# Autodesk Inventor assembly: MM0937AN100_G13_505
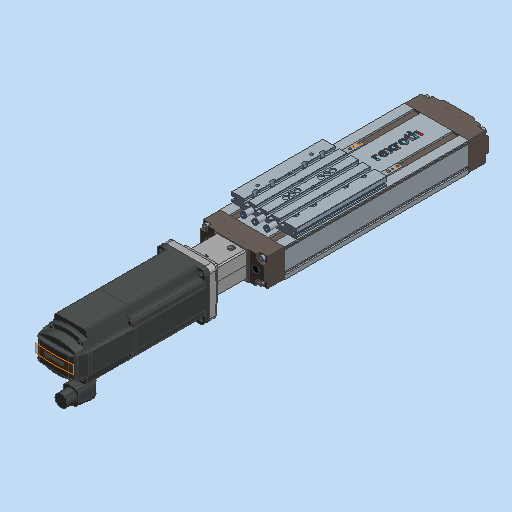
[picture p0: Inventor's stored thumbnail of the model, 512x512]
Saved by Autodesk Inventor 2023.3 (Build 273359000, 359)
## iProperties
Created: 2023-11-29
Part Number: MM0937AN100_G13_505
Document SubType Name: Baugruppe
Designer: RIC7AN
Mass: 24183.6 g
Surface Area: 5600.76 cm^2
Volume: 2935.35 cm^3
Density: 8.23876 g/cm^3
Description: =<RBPARTNOTITLE2>
Vendor: Bosch Rexroth
Sending System: CREO PARAMETRIC BY PTC INC, 2021072
Preprocessor: CREO PARAMETRIC BY PTC INC, 2021072
RBPARTMADEOF: siehe Zeichnung
RBDRAWINGMISSINGSPEC: --
AnP_Kategorie: 11
RBPARTNOTITLE2: CKK110 (L=315mm, P=5mm)
RBGBREMARKSINDEX: E
RBSURFACE: --
RBPARTNOTITLE1: CKK110 (L=315mm, P=5mm)
AnP_Material: =<Material>
RBMATERIAL: =<Material>
RBMATNO: =<Part Number>
RBPARTNO: SIEHE MNR
Title: R036040000_315_ASM
Author: ac91sw
Keywords: =<RBPARTMADEOF>
Comments: =<RBSURFACE2>
Revision Number: 01
## Documents named in this file (3)
- C:\Users\rea9an\Documents\Inventor\TCAI2412_te1910_EM\AS00000907.iam
- C:\Users\rea9an\Documents\Inventor\TCAI2412_te1910_EM\PT00004547.ipt
- C:\Users\rea9an\Documents\Inventor\TCAI2412_te1910_EM\PT00004548.ipt
## Components (2 placed, 2 different names)
1. PT00004547:1 — Fluchtend:3, Fluchtend:4, Passend:2
2. PT00004548:1 — Fluchtend:3, Fluchtend:4, Passend:2
## Relationships (3: Flush 2, Mate 1)
- Fluchtend:3 [Flush]: PT00004547:1 ↔ PT00004548:1
- Fluchtend:4 [Flush] (-17 mm): PT00004547:1 ↔ PT00004548:1
- Passend:2 [Mate] (28 mm): PT00004547:1 ↔ PT00004548:1
